# Autodesk Inventor assembly: Assembly1
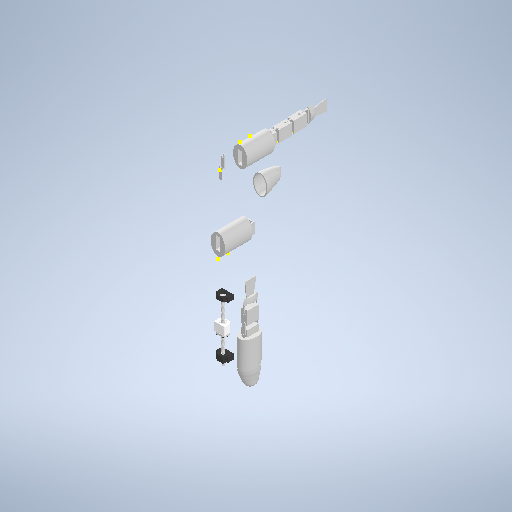
[picture p0: Inventor's stored thumbnail of the model, 512x512]
Saved by Autodesk Inventor 2025.1 (Build 291241020, 241B)
## iProperties
Created: 2026-01-16
Part Number: Assembly1
Document SubType Name: Assembly
Designer: Laptop
Author: Laptop
## iProperties of the stored document cáđầu ca 2_MIR.ipt
Created: 2025-07-17
Part Number: đầu ca 2_MIR
Material: Generic
Document SubType Name: Modeling
Designer: Laptop
Density: 1 g/cm^3
Appearance: Default
Author: Laptop
## iProperties of the stored document cátrục (1).ipt
Created: 2025-07-18
Part Number: trục (1)
Material: Generic
Document SubType Name: Modeling
Designer: Laptop
Density: 1 g/cm^3
Appearance: Default
Author: Laptop
## iProperties of the stored document cánắp đầu cá (1) (1)_MIR.ipt
Created: 2025-07-15
Part Number: nắp đầu cá (1) (1)_MIR
Material: Generic
Document SubType Name: Modeling
Designer: Laptop
Density: 1 g/cm^3
Appearance: Default
Author: Laptop
## iProperties of the stored document SFU1605 Drive Assembly.iam
Created: 2022-09-20
Part Number: SFU1605 Drive Assembly
Document SubType Name: Assembly
Designer: Laptop
Title: G:/My Drive/Misc/Misc 3D Files/Mechanical Stuff/SFU1605 Drive Assembly.step
Sending System: Autodesk Translation Framework v11.7.0.108
Preprocessor: ST-DEVELOPER v19
## iProperties of the stored document cáthanh liên kết đuôi 2.ipt
Created: 2025-07-18
Part Number: thanh liên kết đuôi 2
Material: Generic
Document SubType Name: Modeling
Designer: Laptop
Density: 1 g/cm^3
Appearance: Default
Author: Laptop
## iProperties of the stored document cáthanh liên kết đuôi 1.ipt
Created: 2025-07-18
Part Number: thanh liên kết đuôi 1
Material: Generic
Document SubType Name: Modeling
Designer: Laptop
Density: 1 g/cm^3
Appearance: Default
Author: Laptop
## iProperties of the stored document cáThanh tam giác 1.ipt
Created: 2025-07-18
Part Number: Thanh tam giác 1
Material: Generic
Document SubType Name: Modeling
Designer: Laptop
Density: 1 g/cm^3
Appearance: Default
Author: Laptop
## iProperties of the stored document cánap duoi servo (1) (2).ipt
Created: 2025-07-16
Part Number: nap duoi servo (1) (2)
Material: Generic
Document SubType Name: Modeling
Designer: Laptop
Density: 1 g/cm^3
Appearance: Default
Author: Laptop
## iProperties of the stored document cáthanh tam giác 2.ipt
Created: 2025-07-18
Part Number: thanh tam giác 2
Material: Generic
Document SubType Name: Modeling
Designer: Laptop
Density: 1 g/cm^3
Appearance: Default
Author: Laptop
## iProperties of the stored document SFU1605 Ball Screw Nut v3.ipt
Created: 2026-01-16
Part Number: SFU1605 Ball Screw Nut
Material: Steel
Document SubType Name: Modeling
Designer: Laptop
Density: 7.85 g/cm^3
Appearance: Default
Author: Laptop
## iProperties of the stored document SFU1605 Ball Screw v5.ipt
Created: 2026-01-16
Part Number: SFU1605 Ball Screw
Material: Stainless Steel
Document SubType Name: Modeling
Designer: Laptop
Density: 8 g/cm^3
Appearance: Default
Author: Laptop
## iProperties of the stored document M5 x 20 Socket Head Screw.ipt
Created: 2026-01-16
Part Number: M5 x 20 Socket Head Screw
Material: Aluminum
Document SubType Name: Modeling
Designer: Laptop
Density: 2.7 g/cm^3
Appearance: Default
Author: Laptop
## iProperties of the stored document cáhộp servo (2) (1).ipt
Created: 2025-07-16
Part Number: hộp servo (2) (1)
Material: Generic
Document SubType Name: Modeling
Designer: Laptop
Density: 1 g/cm^3
Appearance: Default
Author: Laptop
## iProperties of the stored document BF12 v4.ipt
Created: 2026-01-16
Part Number: BF12
Material: Steel
Document SubType Name: Modeling
Designer: Laptop
Density: 7.85 g/cm^3
Appearance: Default
Author: Laptop
## iProperties of the stored document cánap tren servo_MIR_MIR.ipt
Created: 2025-07-18
Part Number: nap tren servo_MIR_MIR
Material: Generic
Document SubType Name: Modeling
Designer: Laptop
Density: 1 g/cm^3
Appearance: Default
Author: Laptop
## iProperties of the stored document cáthanh kẹp đuôi (1).ipt
Created: 2025-07-11
Part Number: thanh kẹp đuôi (1)
Material: Generic
Document SubType Name: Modeling
Designer: Laptop
Density: 1 g/cm^3
Appearance: Default
Author: Laptop
## iProperties of the stored document cá ý tưởng.iam
Created: 2026-01-14
Part Number: cá ý tưởng
Document SubType Name: Assembly
Designer: Laptop
Author: Laptop
Sending System: Autodesk Inventor 2025
Preprocessor: ST-DEVELOPER v20
## iProperties of the stored document DSG16H Ball Nut Housing v3.ipt
Created: 2026-01-16
Part Number: DSG16H Ball Nut Housing
Material: Aluminum
Document SubType Name: Modeling
Designer: Laptop
Density: 2.7 g/cm^3
Appearance: Default
Author: Laptop
## iProperties of the stored document BK12 v3.ipt
Created: 2026-01-16
Part Number: BK12
Material: Steel
Document SubType Name: Modeling
Designer: Laptop
Density: 7.85 g/cm^3
Appearance: Default
Author: Laptop
## iProperties of the stored document cáđuôi cá.ipt
Created: 2025-07-10
Part Number: đuôi cá
Material: Generic
Document SubType Name: Modeling
Designer: Laptop
Density: 1 g/cm^3
Appearance: Default
Author: Laptop
## Documents named in this file (34)
- **D:\Year2\đồ án tốt nghịp\Assembly1.iam*LocalDocs*xAaaaardaAaaaaaaaAaaaqxsd2h*cáđầu ca 2_MIR.ipt
- **D:\Year2\đồ án tốt nghịp\Assembly1.iam*LocalDocs*xAaaaa3caAaaaaaaaAaaaqh3oVb*cátrục (1).ipt
- **D:\Year2\đồ án tốt nghịp\Assembly1.iam*LocalDocs*xAaaaa3aaAaaaaaaaAaaaapwnVe*cánắp đầu cá (1) (1)_MIR.ipt
- **D:\Year2\đồ án tốt nghịp\Assembly1.iam*LocalDocs*xAaaaa2daAaaaaaaaAaaaaoyb0f*SFU1605 Drive Assembly.iam
- **D:\Year2\đồ án tốt nghịp\Assembly1.iam*LocalDocs*xAaaaqucaAaaaaaaaAaaaahyiJh*BK12 v3.ipt
- **D:\Year2\đồ án tốt nghịp\Assembly1.iam*LocalDocs*xAaaaq1aaAaaaaaaaAaaaqhzdWa*SFU1605 Ball Screw v5.ipt
- **D:\Year2\đồ án tốt nghịp\Assembly1.iam*LocalDocs*xAaaaqbaaAaaaaaaaAaaaqaha1b*BF12 v4.ipt
- **D:\Year2\đồ án tốt nghịp\Assembly1.iam*LocalDocs*xAaaaq1caAaaaaaaaAaaaq0wdVf*SFU1605 Ball Screw Nut v3.ipt
- **D:\Year2\đồ án tốt nghịp\Assembly1.iam*LocalDocs*xAaaaqxaaAaaaaaaaAaaaafq4Ra*DSG16H Ball Nut Housing v3.ipt
- **D:\Year2\đồ án tốt nghịp\Assembly1.iam*LocalDocs*xAaaaqacaAaaaaaaaAaaaa3jkBf*M5 x 20 Socket Head Screw.ipt
- **D:\Year2\đồ án tốt nghịp\Assembly1.iam*LocalDocs*xAaaaaacaAaaaaaaaAaaaaxjs5b*cáthanh liên kết đuôi 2.ipt
- **D:\Year2\đồ án tốt nghịp\Assembly1.iam*LocalDocs*xAaaaa5baAaaaaaaaAaaaacwcYb*cáthanh liên kết đuôi 1.ipt
- **D:\Year2\đồ án tốt nghịp\Assembly1.iam*LocalDocs*xAaaaaqbaAaaaaaaaAaaaqhfpFa*cáThanh tam giác 1.ipt
- **D:\Year2\đồ án tốt nghịp\Assembly1.iam*LocalDocs*xAaaaqdaaAaaaaaaaAaaaq4lsVf*cánap duoi servo (1) (2).ipt
- **D:\Year2\đồ án tốt nghịp\Assembly1.iam*LocalDocs*xAaaaqacaAaaaaaaaAaaaajqv0h*cáthanh tam giác 2.ipt
- **D:\Year2\đồ án tốt nghịp\Assembly1.iam*LocalDocs*xAaaaqbdaAaaaaaaaAaaaqxmlOb*cáhộp servo (2) (1).ipt
- **D:\Year2\đồ án tốt nghịp\Assembly1.iam*LocalDocs*xAaaaqucaAaaaaaaaAaaaadu2Mh*cánap tren servo_MIR_MIR.ipt
- **D:\Year2\đồ án tốt nghịp\Assembly1.iam*LocalDocs*xAaaaqgbaAaaaaaaaAaaaaml10g*cáthanh kẹp đuôi (1).ipt
- **D:\Year2\đồ án tốt nghịp\Assembly1.iam*LocalDocs*xAaaaqpaaAaaaaaaaAaaaaglhZe*cá ý tưởng.iam
- **D:\Year2\đồ án tốt nghịp\Assembly1.iam*LocalDocs*xAaaaqxcaAaaaaaaaAaaaags0Xc*cáđuôi cá.ipt
- D:\Year2\đồ án tốt nghịp\Assembly1.iam
- D:\Year2\đồ án tốt nghịp\3d\cánắp đầu cá (1) (1)_MIR.ipt
- D:\Year2\đồ án tốt nghịp\3d\cáđầu ca 2_MIR.ipt
- D:\Year2\đồ án tốt nghịp\3d\cáđuôi cá.ipt
- D:\Year2\đồ án tốt nghịp\3d\cáhộp servo (2) (1).ipt
- D:\Year2\đồ án tốt nghịp\3d\cánap duoi servo (1) (2).ipt
- D:\Year2\đồ án tốt nghịp\3d\cánap tren servo_MIR_MIR.ipt
- D:\Year2\đồ án tốt nghịp\3d\cáthanh kẹp đuôi (1).ipt
- D:\Year2\đồ án tốt nghịp\3d\cáthanh liên kết đuôi 1.ipt
- D:\Year2\đồ án tốt nghịp\3d\cáThanh tam giác 1.ipt
- D:\Year2\đồ án tốt nghịp\3d\cáthanh tam giác 2.ipt
- D:\Year2\đồ án tốt nghịp\3d\cátrục (1).ipt
- D:\Year2\đồ án tốt nghịp\cá ý tưởng.stp
- D:\Year2\đồ án tốt nghịp\sfu1605-ball-screw-assembly-1.snapshot.8\SFU1605 Drive Assembly.step
## Components (19 placed, 13 different names)
1. SFU1605 Drive Assembly:1 [sub-assembly]
2. cá ý tưởng:1 [sub-assembly]
3. cánắp đầu cá (1) (1)_MIR:1
4. cáđầu ca 2_MIR:1
5. cáđuôi cá:1 — Mate:27, Mate:28
6. cáhộp servo (2) (1):1 — Mate:1, Mate:2, Mate:3, Mate:7, Mate:8
7. cánắp đầu cá (1) (1)_MIR:2 — Mate:20, Mate:22
8. cánap duoi servo (1) (2):1 — Mate:1, Mate:2, Mate:3
9. cánap tren servo_MIR_MIR:1 — Mate:7, Mate:8, Mate:14, Mate:15, Mate:21, Mate:23
10. cáthanh kẹp đuôi (1):1 — Mate:24, Mate:25, Mate:26, Mate:27, Mate:28
11. cáthanh liên kết đuôi 1:1 — Mate:14, Mate:15, Mate:16, Mate:17
12. cáThanh tam giác 1:1
13. cáthanh tam giác 2:1
14. cátrục (1):1
15. cáhộp servo (2) (1):2
16. cánap duoi servo (1) (2):2
17. cánap tren servo_MIR_MIR:2 — Mate:16, Mate:17, Mate:18, Mate:19
18. cáthanh liên kết đuôi 1:2 — Mate:18, Mate:19, Mate:24, Mate:25, Mate:26
19. cáthanh liên kết đuôi 1:3 — Mate:20, Mate:21, Mate:22, Mate:23
## Relationships (25: Mate 25)
- Mate:1: cáhộp servo (2) (1):1 ↔ cánap duoi servo (1) (2):1
- Mate:2: cáhộp servo (2) (1):1 ↔ cánap duoi servo (1) (2):1
- Mate:3: cáhộp servo (2) (1):1 ↔ cánap duoi servo (1) (2):1
- Mate:7: cáhộp servo (2) (1):1 ↔ cánap tren servo_MIR_MIR:1
- Mate:8: cáhộp servo (2) (1):1 ↔ cánap tren servo_MIR_MIR:1
- [Mate]: cáhộp servo (2) (1):2 ↔ cánap duoi servo (1) (2):2
- [Mate]: cáhộp servo (2) (1):2 ↔ cánap duoi servo (1) (2):2
- [Mate]: cáhộp servo (2) (1):2 ↔ cánap duoi servo (1) (2):2
- [Mate]: cáhộp servo (2) (1):2 ↔ cánap tren servo_MIR_MIR:2
- [Mate]: cáhộp servo (2) (1):2 ↔ cánap tren servo_MIR_MIR:2
- Mate:14: cánap tren servo_MIR_MIR:1 ↔ cáthanh liên kết đuôi 1:1
- Mate:15: cánap tren servo_MIR_MIR:1 ↔ cáthanh liên kết đuôi 1:1
- Mate:16: cáthanh liên kết đuôi 1:1 ↔ cánap tren servo_MIR_MIR:2
- Mate:17: cáthanh liên kết đuôi 1:1 ↔ cánap tren servo_MIR_MIR:2
- Mate:18: cánap tren servo_MIR_MIR:2 ↔ cáthanh liên kết đuôi 1:2
- Mate:19: cánap tren servo_MIR_MIR:2 ↔ cáthanh liên kết đuôi 1:2
- Mate:20: cánắp đầu cá (1) (1)_MIR:2 ↔ cáthanh liên kết đuôi 1:3
- Mate:21: cánap tren servo_MIR_MIR:1 ↔ cáthanh liên kết đuôi 1:3
- Mate:22: cánắp đầu cá (1) (1)_MIR:2 ↔ cáthanh liên kết đuôi 1:3
- Mate:23: cánap tren servo_MIR_MIR:1 ↔ cáthanh liên kết đuôi 1:3
- Mate:24: cáthanh kẹp đuôi (1):1 ↔ cáthanh liên kết đuôi 1:2
- Mate:25: cáthanh kẹp đuôi (1):1 ↔ cáthanh liên kết đuôi 1:2
- Mate:26: cáthanh kẹp đuôi (1):1 ↔ cáthanh liên kết đuôi 1:2
- Mate:27: cáđuôi cá:1 ↔ cáthanh kẹp đuôi (1):1
- Mate:28: cáđuôi cá:1 ↔ cáthanh kẹp đuôi (1):1
## Named parameters: d13_d2 = 0 mm, d14_d3 = 0 mm, d15_d4 = 0 mm, d16_d11 = 0 mm, d17_d12 = 0 mm
